# Autodesk Inventor assembly: PCB-B 1
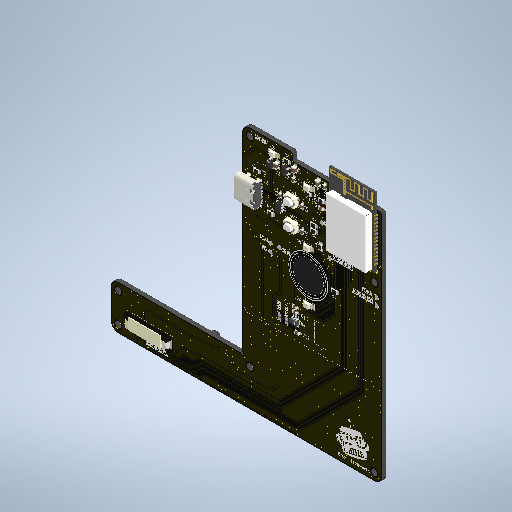
[picture p0: Inventor's stored thumbnail of the model, 512x512]
Saved by Autodesk Inventor 2025.2 (Build 292293000, 293)
## iProperties
Created: 2026-06-16
Part Number: PCB-B 1
Description: KiCad electronic assembly
Document SubType Name: Assembly
Designer: AdminForWorker
Title: PCB-B v1
Author: AdminForWorker
## Documents named in this file (24)
- D:\GITHUB\esp32-based-iot-switch\CAD\PCB-B\PCB-B.iam
- D:\GITHUB\esp32-based-iot-switch\CAD\PCB-B\C_0805_2012Metric.ipt
- D:\GITHUB\esp32-based-iot-switch\CAD\PCB-B\LED_1206_3216Metric.ipt
- D:\GITHUB\esp32-based-iot-switch\CAD\PCB-B\R_0805_2012Metric.ipt
- D:\GITHUB\esp32-based-iot-switch\CAD\PCB-B\C_0603_1608Metric.ipt
- D:\GITHUB\esp32-based-iot-switch\CAD\PCB-B\ESP32-C5-WROOM-1_V1_3_20250619_0.iam
- D:\GITHUB\esp32-based-iot-switch\CAD\PCB-B\SOT-23-6.ipt
- D:\GITHUB\esp32-based-iot-switch\CAD\PCB-B\SOT-23-5.ipt
- D:\GITHUB\esp32-based-iot-switch\CAD\PCB-B\SW_SPST_PTS810.ipt
- D:\GITHUB\esp32-based-iot-switch\CAD\PCB-B\USB_C_Receptacle_GCT_USB4105-xx-A_16P_TopMnt_Horizontal.ipt
- D:\GITHUB\esp32-based-iot-switch\CAD\PCB-B\D_SOD-123.ipt
- D:\GITHUB\esp32-based-iot-switch\CAD\PCB-B\TTP223-BA6.ipt
- D:\GITHUB\esp32-based-iot-switch\CAD\PCB-B\FPC_24P_0.5mm.ipt
- D:\GITHUB\esp32-based-iot-switch\CAD\PCB-B\NR3015T100M.ipt
- D:\GITHUB\esp32-based-iot-switch\CAD\PCB-B\PinHeader_2x03_P2.54mm_Vertical_SMD.ipt
- D:\GITHUB\esp32-based-iot-switch\CAD\PCB-B\SOT-23.ipt
- D:\GITHUB\esp32-based-iot-switch\CAD\PCB-B\ESP32C5_iot_switch_copper.ipt
- D:\GITHUB\esp32-based-iot-switch\CAD\PCB-B\ESP32C5_iot_switch_pad.ipt
- D:\GITHUB\esp32-based-iot-switch\CAD\PCB-B\ESP32C5_iot_switch_via.ipt
- D:\GITHUB\esp32-based-iot-switch\CAD\PCB-B\ESP32C5_iot_switch_silkscreen.ipt
- D:\GITHUB\esp32-based-iot-switch\CAD\PCB-B\ESP32C5_iot_switch_silkscreen (1).ipt
- D:\GITHUB\esp32-based-iot-switch\CAD\PCB-B\ESP32C5_iot_switch_soldermask.ipt
- D:\GITHUB\esp32-based-iot-switch\CAD\PCB-B\ESP32C5_iot_switch_soldermask (1).ipt
- D:\GITHUB\esp32-based-iot-switch\CAD\PCB-B\ESP32C5_iot_switch_PCB.ipt
## Components (61 placed, 23 different names)
1. C_0805_2012Metric:1
2. LED_1206_3216Metric:1
3. R_0805_2012Metric:1
4. C_0603_1608Metric:1
5. ESP32-C5-WROOM-1_V1_3_20250619_0:1 [sub-assembly]
6. SOT-23-6:1
7. SOT-23-5:1
8. SW_SPST_PTS810:1
9. USB_C_Receptacle_GCT_USB4105-xx-A_16P_TopMnt_Horizontal:1
10. D_SOD-123:1
11. TTP223-BA6:1
12. FPC_24P_0.5mm:1
13. NR3015T100M:1
14. PinHeader_2x03_P2.54mm_Vertical_SMD:1
15. SOT-23:1
16. ESP32C5_iot_switch_copper:1
17. ESP32C5_iot_switch_pad:1
18. ESP32C5_iot_switch_via:1
19. ESP32C5_iot_switch_silkscreen:1
20. ESP32C5_iot_switch_silkscreen (1):1
21. ESP32C5_iot_switch_soldermask:1
22. ESP32C5_iot_switch_soldermask (1):1
23. ESP32C5_iot_switch_PCB:1
24. C_0805_2012Metric:2
25. LED_1206_3216Metric:2
26. C_0805_2012Metric:3
27. R_0805_2012Metric:2
28. C_0603_1608Metric:2
29. C_0603_1608Metric:3
30. R_0805_2012Metric:3
31. C_0603_1608Metric:4
32. C_0603_1608Metric:5
33. C_0603_1608Metric:6
34. R_0805_2012Metric:4
35. R_0805_2012Metric:5
36. R_0805_2012Metric:6
37. LED_1206_3216Metric:3
38. LED_1206_3216Metric:4
39. R_0805_2012Metric:7
40. C_0603_1608Metric:7
41. R_0805_2012Metric:8
42. C_0603_1608Metric:8
43. C_0603_1608Metric:9
44. R_0805_2012Metric:9
45. SW_SPST_PTS810:2
46. C_0603_1608Metric:10
47. C_0603_1608Metric:11
48. R_0805_2012Metric:10
49. C_0805_2012Metric:4
50. C_0603_1608Metric:12
51. C_0603_1608Metric:13
52. R_0805_2012Metric:11
53. R_0805_2012Metric:12
54. C_0603_1608Metric:14
55. C_0805_2012Metric:5
56. D_SOD-123:2
57. C_0603_1608Metric:15
58. D_SOD-123:3
59. C_0603_1608Metric:16
60. C_0603_1608Metric:17
61. D_SOD-123:4
## Named parameters: Finish1_Area = 58.2397, Finish2_Area = 59.6479
note: some values were not read from the file. Shown as the stored number, unit unknown: "Finish1_Area", "Finish2_Area".
